# Autodesk Inventor assembly: mate-edge
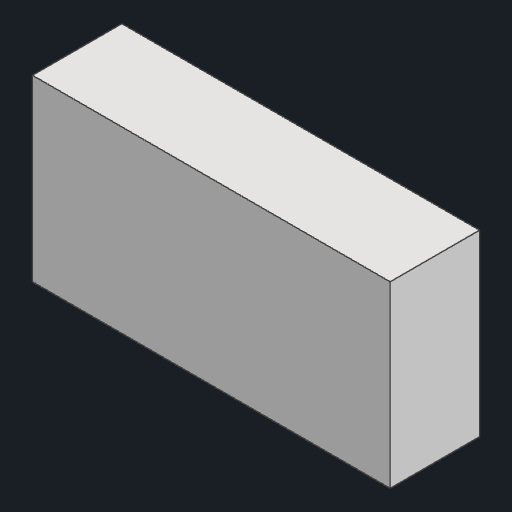
[picture p0: Inventor's stored thumbnail of the model, 512x512]
Saved by Autodesk Inventor 2026.1 (Build 301233000, 233)
## iProperties
Created: 2026-10-30
Part Number: mate-edge
Document SubType Name: Assembly
Designer: anony
Author: anony
## Documents named in this file (2)
- C:\Users\anony\OneDrive\Desktop\AI Projects\CAD Convert\corpus\generated\asm\mate-edge.iam
- C:\Users\anony\OneDrive\Desktop\AI Projects\CAD Convert\corpus\generated\asmparts\box.ipt
## Components (2 placed, 1 different names)
1. box:1 — Mate:1
2. box:2 — Mate:1
## Relationships (1: Mate 1)
- Mate:1: box:1 ↔ box:2
